# Autodesk Inventor assembly: drivetrain
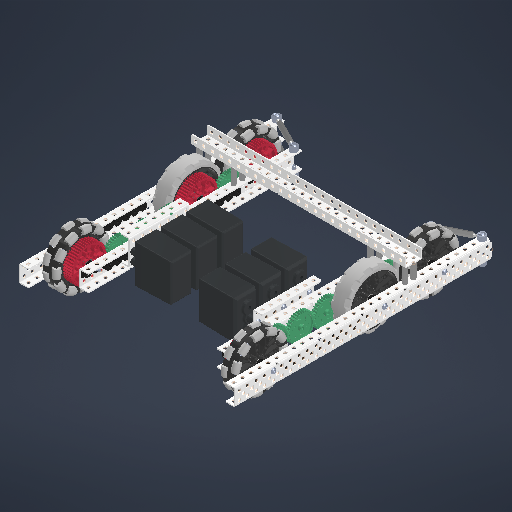
[picture p0: Inventor's stored thumbnail of the model, 512x512]
Saved by Autodesk Inventor 2026.2 (Build 302298000, 298)
## iProperties
Created: 2026-11-05
Part Number: drivetrain
Document SubType Name: Assembly
Designer: BuddyProject
Author: BuddyProject
## Documents named in this file (4)
- E:\593C-CAD-26-27\drivetrain.iam
- E:\593C-CAD-26-27\halfdrivetrain.iam
- E:\VEX-CAD-Inventor-main\Structure\C Channel\Aluminum 1x2x1\Alu C 1x2x1x25.ipt
- E:\593C-CAD-26-27\Mirrored Parts\halfdrivetrain_MIR.iam
## Components (3 placed, 3 different names)
1. halfdrivetrain:1 [sub-assembly] — Mate:1, Mate:2, Mate:3, Mate:4
2. Alu C 1x2x1x25:1 — Mate:1, Mate:2, Mate:3, Mate:4, Mate:5, Mate:6, Mate:7
3. halfdrivetrain_MIR:1 [sub-assembly] — Mate:5, Mate:6, Mate:7
## Relationships (7: Mate 7)
- Mate:1: halfdrivetrain:1 ↔ Alu C 1x2x1x25:1
- Mate:2: halfdrivetrain:1 ↔ Alu C 1x2x1x25:1
- Mate:3: halfdrivetrain:1 ↔ Alu C 1x2x1x25:1
- Mate:4: halfdrivetrain:1 ↔ Alu C 1x2x1x25:1
- Mate:5: Alu C 1x2x1x25:1 ↔ halfdrivetrain_MIR:1
- Mate:6: Alu C 1x2x1x25:1 ↔ halfdrivetrain_MIR:1
- Mate:7: Alu C 1x2x1x25:1 ↔ halfdrivetrain_MIR:1
